# Autodesk Inventor assembly: sertar_asm
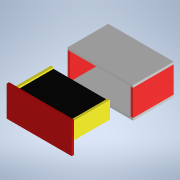
[picture p0: Inventor's stored thumbnail of the model, 180x180]
Saved by Autodesk Inventor 2022.6 (Build 266554000, 554)
## iProperties
Created: 2025-04-23
Part Number: sertar_asm
Document SubType Name: Assembly
Designer: Dragos Macovei
Author: Dragos Macovei
## Documents named in this file (7)
- C:\Users\Dragos Macovei\Documents\Inventor_3d_parts\PAT\Pat_Colt_tara_190_125_26\Noptiera 500x318\sertar_asm.iam
- C:\Users\Dragos Macovei\Documents\Inventor_3d_parts\PAT\Pat_Colt_tara_190_125_26\Noptiera 500x318\capac_noptiera_sus_jos.ipt
- C:\Users\Dragos Macovei\Documents\Inventor_3d_parts\PAT\Pat_Colt_tara_190_125_26\Noptiera 500x318\laterala_noptiera(stg-dr).ipt
- C:\Users\Dragos Macovei\Documents\Inventor_3d_parts\PAT\Pat_Colt_tara_190_125_26\Noptiera 500x318\laterala_sertar.ipt
- C:\Users\Dragos Macovei\Documents\Inventor_3d_parts\PAT\Pat_Colt_tara_190_125_26\Noptiera 500x318\fata_spate_sertar.ipt
- C:\Users\Dragos Macovei\Documents\Inventor_3d_parts\PAT\Pat_Colt_tara_190_125_26\Noptiera 500x318\fund_sertar.ipt
- C:\Users\Dragos Macovei\Documents\Inventor_3d_parts\PAT\Pat_Colt_tara_190_125_26\Noptiera 500x318\front_noptiera.ipt
## Components (10 placed, 6 different names)
1. capac_noptiera_sus_jos:1 — Mate:1, Flush:1, Mate:2, Flush:2, Flush:3, Flush:4, Mate:9
2. capac_noptiera_sus_jos:2 — Mate:3, Flush:5, Flush:6, Flush:17
3. laterala_noptiera(stg-dr):1 — Mate:1, Flush:1, Flush:4, Flush:15, Flush:16
4. laterala_noptiera(stg-dr):2 — Mate:2, Flush:2, Flush:3, Mate:3, Flush:5, Flush:6
5. laterala_sertar:1 — Mate:4, Flush:8, Flush:9, Mate:6, Flush:13
6. laterala_sertar:2 — Mate:5, Flush:7, Flush:10, Flush:11, Flush:12, Mate:8, Flush:15
7. fata_spate_sertar:1 — Mate:4, Mate:5, Flush:7, Flush:8, Flush:9, Flush:10, Mate:10
8. fata_spate_sertar:2 — Mate:6, Flush:11, Flush:12, Flush:13, Mate:7, Flush:14
9. fund_sertar:1 — Mate:7, Mate:8, Flush:14, Mate:9
10. front_noptiera:1 — Mate:10, Flush:16, Flush:17
## Relationships (27: Flush 17, Mate 10)
- Mate:1: capac_noptiera_sus_jos:1 ↔ laterala_noptiera(stg-dr):1
- Flush:1: capac_noptiera_sus_jos:1 ↔ laterala_noptiera(stg-dr):1
- Mate:2: capac_noptiera_sus_jos:1 ↔ laterala_noptiera(stg-dr):2
- Flush:2: capac_noptiera_sus_jos:1 ↔ laterala_noptiera(stg-dr):2
- Flush:3: capac_noptiera_sus_jos:1 ↔ laterala_noptiera(stg-dr):2
- Flush:4: capac_noptiera_sus_jos:1 ↔ laterala_noptiera(stg-dr):1
- Mate:3: capac_noptiera_sus_jos:2 ↔ laterala_noptiera(stg-dr):2
- Flush:5: capac_noptiera_sus_jos:2 ↔ laterala_noptiera(stg-dr):2
- Flush:6: capac_noptiera_sus_jos:2 ↔ laterala_noptiera(stg-dr):2
- Mate:4: laterala_sertar:1 ↔ fata_spate_sertar:1
- Mate:5: laterala_sertar:2 ↔ fata_spate_sertar:1
- Flush:7: laterala_sertar:2 ↔ fata_spate_sertar:1
- Flush:8: laterala_sertar:1 ↔ fata_spate_sertar:1
- Flush:9: laterala_sertar:1 ↔ fata_spate_sertar:1
- Flush:10: laterala_sertar:2 ↔ fata_spate_sertar:1
- Mate:6: laterala_sertar:1 ↔ fata_spate_sertar:2
- Flush:11: laterala_sertar:2 ↔ fata_spate_sertar:2
- Flush:12: laterala_sertar:2 ↔ fata_spate_sertar:2
- Flush:13: laterala_sertar:1 ↔ fata_spate_sertar:2
- Mate:7: fata_spate_sertar:2 ↔ fund_sertar:1
- Mate:8: laterala_sertar:2 ↔ fund_sertar:1
- Flush:14: fata_spate_sertar:2 ↔ fund_sertar:1
- Flush:15 (-24.5 mm): laterala_noptiera(stg-dr):1 ↔ laterala_sertar:2
- Mate:9 (28 mm): capac_noptiera_sus_jos:1 ↔ fund_sertar:1
- Mate:10: fata_spate_sertar:1 ↔ front_noptiera:1
- Flush:16: laterala_noptiera(stg-dr):1 ↔ front_noptiera:1
- Flush:17: capac_noptiera_sus_jos:2 ↔ front_noptiera:1
